# Autodesk Inventor assembly: Assembly4
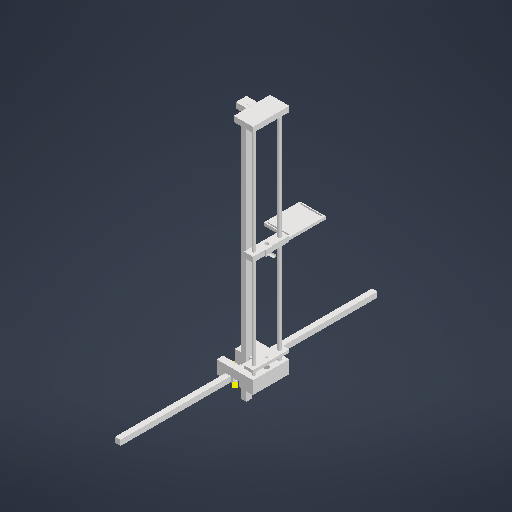
[picture p0: Inventor's stored thumbnail of the model, 512x512]
Saved by Autodesk Inventor 2027.1 (Build 311270010, 270A)
## iProperties
Created: 2026-10-10
Part Number: Assembly4
Document SubType Name: Assembly
Designer: khaar
Author: khaar
## Documents named in this file (9)
- C:\Users\khaar\final_year\Assembly4.iam
- C:\Users\khaar\final_year\neck.ipt
- C:\Users\khaar\final_year\guard_rail.ipt
- C:\Users\khaar\final_year\top_holder.ipt
- C:\Users\khaar\final_year\bearing_housing.ipt
- C:\Users\khaar\final_year\NutHousing.ipt
- C:\Users\khaar\final_year\Base.ipt
- C:\Users\khaar\final_year\barHoldeript.ipt
- C:\Users\khaar\final_year\prints\circuitHolder.ipt
## Components (10 placed, 8 different names)
1. neck:1 — Rigid:1, Rigid:2
2. guard_rail:1 — Rotational:1, Rotational:2, Rigid:5, Rigid:6
3. guard_rail:2 — Rigid:3, Rigid:4, Rotational:3, Rotational:4
4. top_holder:6 — Rigid:2, Rotational:1, Rigid:3
5. bearing_housing:1 — Rigid:6, Rotational:4, Rigid:7, Rigid:8
6. NutHousing:2 — Rigid:5, Rotational:3
7. Base:1 — Rotational:2, Rigid:4
8. neck:2 — Rigid:1
9. barHoldeript:1 — Rigid:7
10. circuitHolder:3 — Rigid:8
## Relationships (12: WeldJoint 8, RevoluteJoint 4)
- Rigid:1 [WeldJoint] (-140 mm): neck:1 ↔ neck:2
- Rigid:2 [WeldJoint]: neck:1 ↔ top_holder:6
- Rotational:1 [RevoluteJoint]: guard_rail:1 ↔ top_holder:6
- Rigid:3 [WeldJoint]: guard_rail:2 ↔ top_holder:6
- Rotational:2 [RevoluteJoint]: guard_rail:1 ↔ Base:1
- Rigid:4 [WeldJoint]: guard_rail:2 ↔ Base:1
- Rigid:5 [WeldJoint] (-40 mm): guard_rail:1 ↔ NutHousing:2
- Rotational:3 [RevoluteJoint] (-40 mm): guard_rail:2 ↔ NutHousing:2
- Rigid:6 [WeldJoint]: guard_rail:1 ↔ bearing_housing:1
- Rotational:4 [RevoluteJoint] (10 mm): guard_rail:2 ↔ bearing_housing:1
- Rigid:7 [WeldJoint]: bearing_housing:1 ↔ barHoldeript:1
- Rigid:8 [WeldJoint]: bearing_housing:1 ↔ circuitHolder:3
